# Autodesk Inventor assembly: S3v2
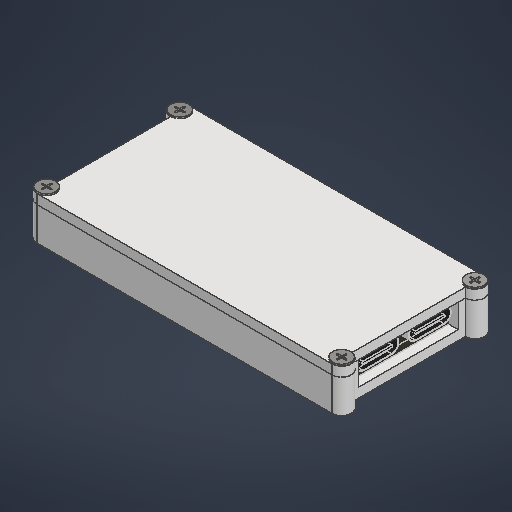
[picture p0: Inventor's stored thumbnail of the model, 512x512]
Saved by Autodesk Inventor 2027.1 (Build 311270010, 270A)
## iProperties
Created: 2026-09-27
Part Number: S3v2
Document SubType Name: Assembly
Designer: work
Author: work
## Documents named in this file (5)
- C:\Users\work\Desktop\Mini WebServer\모델링\S3_V2\S3v2.iam
- C:\Users\work\Desktop\Mini WebServer\모델링\S3_V2\COVER.ipt
- C:\Users\work\Desktop\Mini WebServer\모델링\S3_V2\ESP32-S3.ipt
- C:\Users\work\Desktop\Mini WebServer\모델링\S3_V2\CASE.ipt
- C:\Users\work\Desktop\Mini WebServer\모델링\D1_V1\JIS B 1122 - ST2.2 x 6.5 - C - H(1).ipt
## Components (7 placed, 4 different names)
1. COVER:1 — 메이트:4, 메이트:5, 메이트:6, 삽입:1, 삽입:2, 삽입:3, 삽입:4
2. ESP32-S3:1 — 메이트:1, 메이트:2, 메이트:3
3. CASE:1 — 메이트:1, 메이트:2, 메이트:3, 메이트:4, 메이트:5, 메이트:6
4. JIS B 1122 - ST2.2 x 6.5 - C - H(1):1 — 삽입:1
5. JIS B 1122 - ST2.2 x 6.5 - C - H(1):2 — 삽입:2
6. JIS B 1122 - ST2.2 x 6.5 - C - H(1):3 — 삽입:3
7. JIS B 1122 - ST2.2 x 6.5 - C - H(1):4 — 삽입:4
## Relationships (10: Mate 6, Insert 4)
- 메이트:1 [Mate]: ESP32-S3:1 ↔ CASE:1
- 메이트:2 [Mate]: ESP32-S3:1 ↔ CASE:1
- 메이트:3 [Mate] (0.5 mm): ESP32-S3:1 ↔ CASE:1
- 메이트:4 [Mate]: COVER:1 ↔ CASE:1
- 메이트:5 [Mate]: COVER:1 ↔ CASE:1
- 메이트:6 [Mate]: COVER:1 ↔ CASE:1
- 삽입:1 [Insert]: COVER:1 ↔ JIS B 1122 - ST2.2 x 6.5 - C - H(1):1
- 삽입:2 [Insert]: COVER:1 ↔ JIS B 1122 - ST2.2 x 6.5 - C - H(1):2
- 삽입:3 [Insert]: COVER:1 ↔ JIS B 1122 - ST2.2 x 6.5 - C - H(1):3
- 삽입:4 [Insert]: COVER:1 ↔ JIS B 1122 - ST2.2 x 6.5 - C - H(1):4
